# Autodesk Inventor assembly: ensamblaje manivela
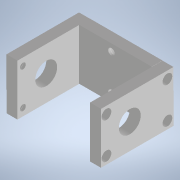
[picture p0: Inventor's stored thumbnail of the model, 180x180]
Saved by Autodesk Inventor 2020.2 (Build 242310000, 310)
## iProperties
Created: 2020-09-29
Part Number: ensamblaje manivela
Document SubType Name: Assembly
Designer: Salvador
Author: Salvador
## Documents named in this file (3)
- C:\Users\Salvador\Documents\Curso 20-21\Utillaje Chapa\Proyecto 1 Matriz\ensamblaje manivela.iam
- C:\Users\Salvador\Documents\Curso 20-21\Utillaje Chapa\Proyecto 1 Matriz\Subconjunto palanca - pieza eje.ipt
- C:\Users\Salvador\Documents\Curso 20-21\Utillaje Chapa\Proyecto 1 Matriz\Subconjunto palanca - pieza eje 2.ipt
## Components (3 placed, 2 different names)
1. Subconjunto palanca - pieza eje:1 — Coincidencia:1, Coincidencia:2, Coincidencia:3
2. Subconjunto palanca - pieza eje:2 — Coincidencia:4, Coincidencia:5, Coincidencia:6
3. Subconjunto palanca - pieza eje 2:1 — Coincidencia:1, Coincidencia:2, Coincidencia:3, Coincidencia:4, Coincidencia:5, Coincidencia:6
## Relationships (6: Mate 6)
- Coincidencia:1 [Mate]: Subconjunto palanca - pieza eje:1 ↔ Subconjunto palanca - pieza eje 2:1
- Coincidencia:2 [Mate]: Subconjunto palanca - pieza eje:1 ↔ Subconjunto palanca - pieza eje 2:1
- Coincidencia:3 [Mate]: Subconjunto palanca - pieza eje:1 ↔ Subconjunto palanca - pieza eje 2:1
- Coincidencia:4 [Mate]: Subconjunto palanca - pieza eje:2 ↔ Subconjunto palanca - pieza eje 2:1
- Coincidencia:5 [Mate]: Subconjunto palanca - pieza eje:2 ↔ Subconjunto palanca - pieza eje 2:1
- Coincidencia:6 [Mate]: Subconjunto palanca - pieza eje:2 ↔ Subconjunto palanca - pieza eje 2:1
